# Autodesk Inventor assembly: MM0948AN170_G00_813
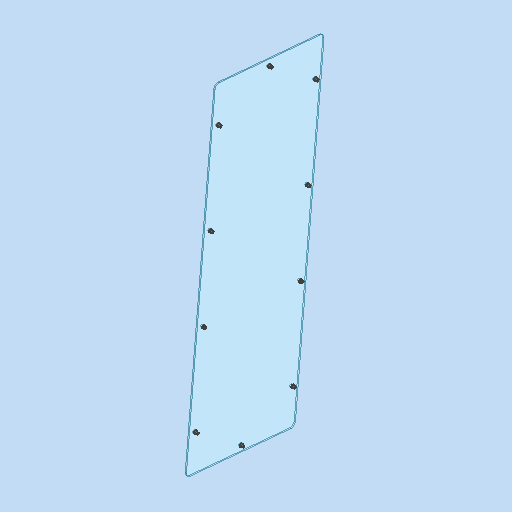
[picture p0: Inventor's stored thumbnail of the model, 512x512]
Saved by Autodesk Inventor 2023.3 (Build 273359000, 359)
## iProperties
RuleStatus: InUse
Created: 2023-03-23
Part Number: MM0948AN170_G00_813
Description: =<RBPARTNOTITLE2>
Document SubType Name: Assembly
Designer: FH/Wi
Mass: 822.818 g
Surface Area: 4594.41 cm^2
Volume: 674.623 cm^3
Density: 1.21967 g/cm^3
AnP_Kategorie: 98
AnP_Material: =<Material>
AnP_TemplVers: 20200821
RBDOCUMENTTYPE: DRF
RBDOCUMENTVERSION: 00
RBDRAWINGMAINSCALE: 1:1
RBDRAWINGMISSINGSPEC: --
RBDRAWINGVOLUME: --
RBDSV1: 0850
RBGBEDGESIN1: +0,5
RBGBEDGESIN2: +0,2
RBGBEDGESOUT1: -0,3
RBGBEDGESOUT2: -0,1
RBMATERIAL: =<Material>
RBMATMEETS: --
RBMATNO: =<Part Number>
RBPARTMADEOF: --
RBPARTNO: SIEHE MNR
RBPARTNOTITLE1: enter description here
RBPARTNOTITLE2: hier Bezeichnung eintragen
RBPARTSAFETYINDICATOR: --
RBSURFACE: --
RBSURFACE2: --
RBZEDGESNORM: ISO13715:2002-06
RBZGENDIMCLASS: m
RBZGENDIMNORM: ISO 2768-1:1989-11
RBZGENGEOCLASS: H
RBZGENGEONORM: ISO 2768-2:1989-11
RBZSURFACENORM: ISO13D2:2002-02
RBZTOLERANCENORM: ISO 14405-1:2010-12
Author: FH/Wi
Keywords: =<RBPARTMADEOF>
Comments: =<RBSURFACE2>
Revision Number: 01
## Documents named in this file (4)
- C:\Users\rea9an\Documents\Inventor\TCAI2412_te1910_EM\AS00000964.iam
- C:\Users\rea9an\Documents\Inventor\TCAI2412_te1910_EM\PT00004822.ipt
- C:\Users\rea9an\Documents\Inventor\TCAI2412_te1910_EM\PT00004778.ipt
- C:\Users\rea9an\Documents\Inventor\TCAI2412_te1910_EM\PT00004705.ipt
## Components (21 placed, 3 different names)
1. PT00004705:1 — Einfügen:18, Einfügen:20, Einfügen:21, Einfügen:22, Einfügen:23, Einfügen:25, Einfügen:27, Einfügen:28, Einfügen:30, Einfügen:31
2. PT00004822:2
3. PT00004778:2 — Einfügen:18
4. PT00004822:4
5. PT00004778:4 — Einfügen:20
6. PT00004822:5
7. PT00004778:5 — Einfügen:21
8. PT00004822:6
9. PT00004778:6 — Einfügen:22
10. PT00004822:7
11. PT00004778:7 — Einfügen:23
12. PT00004822:9
13. PT00004778:9 — Einfügen:25
14. PT00004822:11
15. PT00004778:11 — Einfügen:27
16. PT00004822:12
17. PT00004778:12 — Einfügen:28
18. PT00004822:13
19. PT00004778:13 — Einfügen:30
20. PT00004822:14
21. PT00004778:14 — Einfügen:31
## Relationships (20: Insert 20)
- [Insert]: PT00004822:2 ↔ PT00004778:2
- [Insert]: PT00004822:4 ↔ PT00004778:4
- [Insert]: PT00004822:5 ↔ PT00004778:5
- [Insert]: PT00004822:6 ↔ PT00004778:6
- [Insert]: PT00004822:7 ↔ PT00004778:7
- [Insert]: PT00004822:9 ↔ PT00004778:9
- [Insert]: PT00004822:11 ↔ PT00004778:11
- [Insert]: PT00004822:12 ↔ PT00004778:12
- [Insert]: PT00004822:13 ↔ PT00004778:13
- [Insert]: PT00004822:14 ↔ PT00004778:14
- Einfügen:18 [Insert]: PT00004705:1 ↔ PT00004778:2
- Einfügen:20 [Insert]: PT00004705:1 ↔ PT00004778:4
- Einfügen:21 [Insert]: PT00004705:1 ↔ PT00004778:5
- Einfügen:22 [Insert]: PT00004705:1 ↔ PT00004778:6
- Einfügen:23 [Insert]: PT00004705:1 ↔ PT00004778:7
- Einfügen:25 [Insert]: PT00004705:1 ↔ PT00004778:9
- Einfügen:27 [Insert]: PT00004705:1 ↔ PT00004778:11
- Einfügen:28 [Insert]: PT00004705:1 ↔ PT00004778:12
- Einfügen:30 [Insert]: PT00004705:1 ↔ PT00004778:13
- Einfügen:31 [Insert]: PT00004705:1 ↔ PT00004778:14
## Named parameters: d1_d809_d804 = 0 mm, d3_d809_d804 = 0 mm, d4_d809_d804 = 0 mm, d5_d809_d804 = 0 mm, d6_d809_d804 = 0 mm, d8_d809_d804 = 0 mm, d10_d809_d804 = 0 mm, d11_d809_d804 = 0 mm, d12_d809_d804 = 0 mm, d13_d809_d804 = 0 mm
